# Autodesk Inventor assembly: MainBody_Assembly
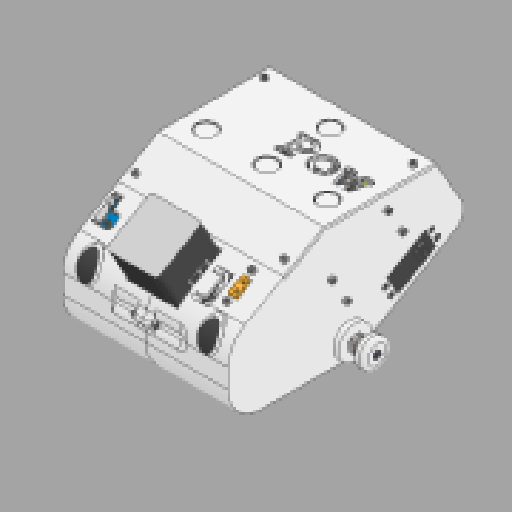
[picture p0: Inventor's stored thumbnail of the model, 512x512]
Saved by Autodesk Inventor 2025 (Build 290162000, 162)
## iProperties
Created: 2024-11-15
Part Number: MainBody_Assembly
Document SubType Name: Assembly
Designer: OSB
Mass: 1535.08 g
Surface Area: 4536.62 cm^2
Volume: 1058.16 cm^3
Density: 1.45071 g/cm^3
Sending System: Autodesk Inventor 2021
Preprocessor: unknown
Minimum Resolution: 0.01
Sent Units: Millimeter
Translation Standard: IGES 5.3
Model Creation Time: 2020-07-07
Title: S500 Frame
Author: OSB
## Documents named in this file (24)
- C:\Users\OSB\Desktop\SB\1.Projects\캡스톤 디자인(2)_Paper\Modeling\Implementation_Design\Ver_004_mass_update\MainBody_Assembly.iam
- C:\Users\OSB\Desktop\SB\1.Projects\캡스톤 디자인(2)_Paper\Modeling\Implementation_Design\Ver_004_mass_update\MainBody_Left.ipt
- C:\Users\OSB\Desktop\SB\1.Projects\캡스톤 디자인(2)_Paper\Modeling\Implementation_Design\Ver_004_mass_update\MainBody_Right.ipt
- C:\Users\OSB\Documents\Inventor\Content Center Files\R2025\ko-KR\KS B 1003\KS B 1003 - M 3 x 20.ipt
- C:\Users\OSB\Documents\Inventor\Content Center Files\R2025\ko-KR\KS B 1012  S2 F\KS B 1012 - M 3(1).ipt
- C:\Users\OSB\Desktop\SB\1.Projects\캡스톤 디자인(2)_Paper\Modeling\Implementation_Design\Ver_004_mass_update\BuckConverter_10A_Assembly.iam
- C:\Users\OSB\Desktop\SB\1.Projects\캡스톤 디자인(2)_Paper\Modeling\Implementation_Design\Ver_004_mass_update\BuckConverter_LM2596_Assembly.iam
- C:\Users\OSB\Desktop\SB\1.Projects\캡스톤 디자인(2)_Paper\Modeling\Implementation_Design\Ver_004_mass_update\InsertNut_M3.ipt
- C:\Users\OSB\Desktop\SB\1.Projects\캡스톤 디자인(2)_Paper\Modeling\Implementation_Design\Ver_004_mass_update\ESP32_Assembly.iam
- C:\Users\OSB\Desktop\SB\1.Projects\캡스톤 디자인(2)_Paper\Modeling\Implementation_Design\Ver_004_mass_update\MPU6050_Assembly.iam
- C:\Users\OSB\Desktop\SB\1.Projects\캡스톤 디자인(2)_Paper\Modeling\Implementation_Design\Ver_004_mass_update\Receiver_Assembly.ipt.iam
- C:\Users\OSB\Desktop\SB\1.Projects\캡스톤 디자인(2)_Paper\Modeling\Implementation_Design\Ver_004_mass_update\Servo_Hip_Assembly.iam
- C:\Users\OSB\Desktop\SB\1.Projects\캡스톤 디자인(2)_Paper\Modeling\Implementation_Design\Ver_004_mass_update\XT60_Assembly.ipt.iam
- C:\Users\OSB\Documents\Inventor\Content Center Files\R2025\ko-KR\KS B 1003\KS B 1003 - M 3 x 10.ipt
- C:\Users\OSB\Documents\Inventor\Content Center Files\R2025\ko-KR\KS B 1003\KS B 1003 - M 2.5 x 16.ipt
- C:\Users\OSB\Desktop\SB\1.Projects\캡스톤 디자인(2)_Paper\Modeling\Implementation_Design\Ver_004_mass_update\ShoulderBolt.ipt
- C:\Users\OSB\Desktop\SB\1.Projects\캡스톤 디자인(2)_Paper\Modeling\Implementation_Design\Ver_004_mass_update\Battery_LiPo_6S_Pack.ipt
- C:\Users\OSB\Desktop\SB\1.Projects\캡스톤 디자인(2)_Paper\Modeling\Implementation_Design\Ver_004_mass_update\MainBody_TopCover.ipt
- C:\Users\OSB\Desktop\SB\1.Projects\캡스톤 디자인(2)_Paper\Modeling\Implementation_Design\Ver_004_mass_update\Washer_6x12.5x1.ipt
- C:\Users\OSB\Documents\Inventor\Content Center Files\R2025\ko-KR\KS B 2023\KS B 2023 - 696 - 6 x 15 x 5 - 1.132.ipt
- C:\Users\OSB\Desktop\SB\1.Projects\캡스톤 디자인(2)_Paper\Modeling\Implementation_Design\Ver_004_mass_update\Spacer_Joint_Assembly.ipt.iam
- Receiver_Assembly.ipt
- XT60_Assembly.ipt
- Spacer_Joint_Assembly.ipt
## Components (67 placed, 20 different names)
1. MainBody_Left:1 — 회전:1, 메이트:1, 삽입:1, 삽입:2, 삽입:3, 삽입:4, 강체:3, 강체:4, 강체:7, 강체:8, 강체:9, 회전:3, 메이트:2, 메이트:5, 메이트:7, 회전:7, 메이트:10, 삽입:9, 삽입:10, 삽입:11, 삽입:12, 삽입:13, 삽입:14, 회전:8, 메이트:11, 삽입:21, 삽입:22, 삽입:23, 삽입:24, 강체:12, 메이트:13, 메이트:14, 강체:21
2. MainBody_Right:1 — 회전:1, 메이트:1, 삽입:5, 삽입:6, 삽입:7, 삽입:8, 강체:1, 강체:2, 강체:5, 강체:6, 강체:10, 회전:2, 메이트:3, 메이트:6, 회전:6, 메이트:9, 삽입:15, 삽입:16, 삽입:17, 삽입:18, 삽입:19, 삽입:20, 회전:9, 메이트:12, 삽입:25, 삽입:26, 삽입:27, 삽입:28, 강체:11, 메이트:15, 강체:22
3. MainBody_TopCover:1 — 회전:10, 메이트:16, 삽입:29, 삽입:30, 삽입:31, 삽입:32
4. Servo_Hip_Assembly:1 [sub-assembly] — 회전:8, 메이트:11
5. Servo_Hip_Assembly:2 [sub-assembly] — 회전:9, 메이트:12
6. BuckConverter_10A_Assembly:1 [sub-assembly] — 회전:3, 메이트:2
7. BuckConverter_10A_Assembly:2 [sub-assembly] — 회전:2, 메이트:3
8. BuckConverter_LM2596_Assembly:1 [sub-assembly] — 회전:4, 메이트:4
9. ESP32_Assembly:1 [sub-assembly] — 메이트:5, 메이트:6, 메이트:7
10. MPU6050_Assembly:1 [sub-assembly] — 회전:5, 메이트:8
11. Receiver_Assembly.ipt:1 [sub-assembly] — 회전:6, 메이트:9
12. XT60_Assembly.ipt:1 [sub-assembly] — 회전:7, 메이트:10
13. Battery_LiPo_6S_Pack:1 — 메이트:13, 메이트:14, 메이트:15
14. ShoulderBolt:1 — 강체:11
15. ShoulderBolt:2 — 강체:12
16. Washer_6x12.5x1:1 — 강체:15, 강체:22
17. Washer_6x12.5x1:2 — 강체:16, 강체:21
18. Washer_6x12.5x1:3 — 강체:17, 강체:20
19. Washer_6x12.5x1:4 — 강체:18, 강체:19
20. KS B 2023 696 - 6 x 15 x 5:1 — 강체:13, 강체:17
21. KS B 2023 696 - 6 x 15 x 5:2 — 강체:13, 강체:15
22. KS B 2023 696 - 6 x 15 x 5:3 — 강체:14, 강체:16
23. KS B 2023 696 - 6 x 15 x 5:4 — 강체:14, 강체:18
24. Spacer_Joint_Assembly.ipt:1 [sub-assembly] — 강체:19
25. Spacer_Joint_Assembly.ipt:2 [sub-assembly] — 강체:20
26. KS B 1003 - 미터 M 3 x 20:1 — 삽입:1
27. KS B 1003 - 미터 M 3 x 20:2 — 삽입:2
28. KS B 1003 - 미터 M 3 x 20:3 — 삽입:3
29. KS B 1003 - 미터 M 3 x 20:4 — 삽입:4
30. KS B 1003 - 미터 M 3 x 10:13 — 삽입:29
31. KS B 1003 - 미터 M 3 x 10:14 — 삽입:30
32. KS B 1003 - 미터 M 3 x 10:15 — 삽입:31
33. KS B 1003 - 미터 M 3 x 10:16 — 삽입:32
34. KS B 1003 - 미터 M 3 x 10:1 — 삽입:9
35. KS B 1003 - 미터 M 3 x 10:2 — 삽입:10
36. KS B 1003 - 미터 M 3 x 10:3 — 삽입:11
37. KS B 1003 - 미터 M 3 x 10:4 — 삽입:12
38. KS B 1003 - 미터 M 3 x 10:6 — 삽입:13
39. KS B 1003 - 미터 M 3 x 10:5 — 삽입:14
40. KS B 1003 - 미터 M 3 x 10:7 — 삽입:15
41. KS B 1003 - 미터 M 3 x 10:12 — 삽입:16
42. KS B 1003 - 미터 M 3 x 10:11 — 삽입:17
43. KS B 1003 - 미터 M 3 x 10:8 — 삽입:18
44. KS B 1003 - 미터 M 3 x 10:9 — 삽입:19
45. KS B 1003 - 미터 M 3 x 10:10 — 삽입:20
46. KS B 1003 - 미터 M 2.5 x 16:8 — 삽입:21
47. KS B 1003 - 미터 M 2.5 x 16:7 — 삽입:22
48. KS B 1003 - 미터 M 2.5 x 16:6 — 삽입:23
49. KS B 1003 - 미터 M 2.5 x 16:5 — 삽입:24
50. KS B 1003 - 미터 M 2.5 x 16:1 — 삽입:25
51. KS B 1003 - 미터 M 2.5 x 16:4 — 삽입:26
52. KS B 1003 - 미터 M 2.5 x 16:2 — 삽입:27
53. KS B 1003 - 미터 M 2.5 x 16:3 — 삽입:28
54. InsertNut_M3:1 — 강체:5
55. InsertNut_M3:2 — 강체:4, 회전:10
56. InsertNut_M3:3 — 강체:1, 메이트:16
57. InsertNut_M3:4 — 강체:3
58. InsertNut_M3:5 — 강체:2
59. InsertNut_M3:6 — 강체:6, 메이트:4
60. InsertNut_M3:7 — 강체:7, 회전:4
61. InsertNut_M3:8 — 강체:8
62. InsertNut_M3:9 — 강체:9, 메이트:8
63. InsertNut_M3:10 — 강체:10, 회전:5
64. KS B 1012 스타일 2 다듬질 - 미터 M 3:1 — 삽입:5
65. KS B 1012 스타일 2 다듬질 - 미터 M 3:2 — 삽입:6
66. KS B 1012 스타일 2 다듬질 - 미터 M 3:3 — 삽입:7
67. KS B 1012 스타일 2 다듬질 - 미터 M 3:4 — 삽입:8
## Relationships (80: Insert 32, WeldJoint 22, Mate 16, RevoluteJoint 10)
- 회전:1 [RevoluteJoint]: MainBody_Left:1 ↔ MainBody_Right:1
- 메이트:1 [Mate]: MainBody_Left:1 ↔ MainBody_Right:1
- 삽입:1 [Insert]: MainBody_Left:1 ↔ KS B 1003 - 미터 M 3 x 20:1
- 삽입:2 [Insert]: MainBody_Left:1 ↔ KS B 1003 - 미터 M 3 x 20:2
- 삽입:3 [Insert]: MainBody_Left:1 ↔ KS B 1003 - 미터 M 3 x 20:3
- 삽입:4 [Insert]: MainBody_Left:1 ↔ KS B 1003 - 미터 M 3 x 20:4
- 삽입:5 [Insert]: MainBody_Right:1 ↔ KS B 1012 스타일 2 다듬질 - 미터 M 3:1
- 삽입:6 [Insert]: MainBody_Right:1 ↔ KS B 1012 스타일 2 다듬질 - 미터 M 3:2
- 삽입:7 [Insert]: MainBody_Right:1 ↔ KS B 1012 스타일 2 다듬질 - 미터 M 3:3
- 삽입:8 [Insert]: MainBody_Right:1 ↔ KS B 1012 스타일 2 다듬질 - 미터 M 3:4
- 강체:1 [WeldJoint]: MainBody_Right:1 ↔ InsertNut_M3:3
- 강체:2 [WeldJoint]: MainBody_Right:1 ↔ InsertNut_M3:5
- 강체:3 [WeldJoint]: MainBody_Left:1 ↔ InsertNut_M3:4
- 강체:4 [WeldJoint]: MainBody_Left:1 ↔ InsertNut_M3:2
- 강체:5 [WeldJoint]: MainBody_Right:1 ↔ InsertNut_M3:1
- 강체:6 [WeldJoint]: MainBody_Right:1 ↔ InsertNut_M3:6
- 강체:7 [WeldJoint]: MainBody_Left:1 ↔ InsertNut_M3:7
- 강체:8 [WeldJoint]: MainBody_Left:1 ↔ InsertNut_M3:8
- 강체:9 [WeldJoint]: MainBody_Left:1 ↔ InsertNut_M3:9
- 강체:10 [WeldJoint]: MainBody_Right:1 ↔ InsertNut_M3:10
- 회전:2 [RevoluteJoint]: MainBody_Right:1 ↔ BuckConverter_10A_Assembly:2
- 회전:3 [RevoluteJoint]: MainBody_Left:1 ↔ BuckConverter_10A_Assembly:1
- 메이트:2 [Mate]: MainBody_Left:1 ↔ BuckConverter_10A_Assembly:1
- 메이트:3 [Mate]: MainBody_Right:1 ↔ BuckConverter_10A_Assembly:2
- 회전:4 [RevoluteJoint]: BuckConverter_LM2596_Assembly:1 ↔ InsertNut_M3:7
- 메이트:4 [Mate]: BuckConverter_LM2596_Assembly:1 ↔ InsertNut_M3:6
- 메이트:5 [Mate]: MainBody_Left:1 ↔ ESP32_Assembly:1
- 메이트:6 [Mate] (0.25 mm): MainBody_Right:1 ↔ ESP32_Assembly:1
- 메이트:7 [Mate] (0.5 mm): MainBody_Left:1 ↔ ESP32_Assembly:1
- 회전:5 [RevoluteJoint]: MPU6050_Assembly:1 ↔ InsertNut_M3:10
- 메이트:8 [Mate]: MPU6050_Assembly:1 ↔ InsertNut_M3:9
- 회전:6 [RevoluteJoint]: MainBody_Right:1 ↔ Receiver_Assembly.ipt:1
- 메이트:9 [Mate]: MainBody_Right:1 ↔ Receiver_Assembly.ipt:1
- 회전:7 [RevoluteJoint]: MainBody_Left:1 ↔ XT60_Assembly.ipt:1
- 메이트:10 [Mate]: MainBody_Left:1 ↔ XT60_Assembly.ipt:1
- 삽입:9 [Insert]: MainBody_Left:1 ↔ KS B 1003 - 미터 M 3 x 10:1
- 삽입:10 [Insert]: MainBody_Left:1 ↔ KS B 1003 - 미터 M 3 x 10:2
- 삽입:11 [Insert]: MainBody_Left:1 ↔ KS B 1003 - 미터 M 3 x 10:3
- 삽입:12 [Insert]: MainBody_Left:1 ↔ KS B 1003 - 미터 M 3 x 10:4
- 삽입:13 [Insert]: MainBody_Left:1 ↔ KS B 1003 - 미터 M 3 x 10:6
- 삽입:14 [Insert]: MainBody_Left:1 ↔ KS B 1003 - 미터 M 3 x 10:5
- 삽입:15 [Insert]: MainBody_Right:1 ↔ KS B 1003 - 미터 M 3 x 10:7
- 삽입:16 [Insert]: MainBody_Right:1 ↔ KS B 1003 - 미터 M 3 x 10:12
- 삽입:17 [Insert]: MainBody_Right:1 ↔ KS B 1003 - 미터 M 3 x 10:11
- 삽입:18 [Insert]: MainBody_Right:1 ↔ KS B 1003 - 미터 M 3 x 10:8
- 삽입:19 [Insert]: MainBody_Right:1 ↔ KS B 1003 - 미터 M 3 x 10:9
- 삽입:20 [Insert]: MainBody_Right:1 ↔ KS B 1003 - 미터 M 3 x 10:10
- 회전:8 [RevoluteJoint]: MainBody_Left:1 ↔ Servo_Hip_Assembly:1
- 메이트:11 [Mate]: MainBody_Left:1 ↔ Servo_Hip_Assembly:1
- 회전:9 [RevoluteJoint]: MainBody_Right:1 ↔ Servo_Hip_Assembly:2
- 메이트:12 [Mate]: MainBody_Right:1 ↔ Servo_Hip_Assembly:2
- 삽입:21 [Insert]: MainBody_Left:1 ↔ KS B 1003 - 미터 M 2.5 x 16:8
- 삽입:22 [Insert]: MainBody_Left:1 ↔ KS B 1003 - 미터 M 2.5 x 16:7
- 삽입:23 [Insert]: MainBody_Left:1 ↔ KS B 1003 - 미터 M 2.5 x 16:6
- 삽입:24 [Insert]: MainBody_Left:1 ↔ KS B 1003 - 미터 M 2.5 x 16:5
- 삽입:25 [Insert]: MainBody_Right:1 ↔ KS B 1003 - 미터 M 2.5 x 16:1
- 삽입:26 [Insert]: MainBody_Right:1 ↔ KS B 1003 - 미터 M 2.5 x 16:4
- 삽입:27 [Insert]: MainBody_Right:1 ↔ KS B 1003 - 미터 M 2.5 x 16:2
- 삽입:28 [Insert]: MainBody_Right:1 ↔ KS B 1003 - 미터 M 2.5 x 16:3
- 강체:11 [WeldJoint]: MainBody_Right:1 ↔ ShoulderBolt:1
- 강체:12 [WeldJoint]: MainBody_Left:1 ↔ ShoulderBolt:2
- 메이트:13 [Mate]: MainBody_Left:1 ↔ Battery_LiPo_6S_Pack:1
- 메이트:14 [Mate]: MainBody_Left:1 ↔ Battery_LiPo_6S_Pack:1
- 메이트:15 [Mate]: MainBody_Right:1 ↔ Battery_LiPo_6S_Pack:1
- 회전:10 [RevoluteJoint]: MainBody_TopCover:1 ↔ InsertNut_M3:2
- 메이트:16 [Mate]: MainBody_TopCover:1 ↔ InsertNut_M3:3
- 삽입:29 [Insert]: MainBody_TopCover:1 ↔ KS B 1003 - 미터 M 3 x 10:13
- 삽입:30 [Insert]: MainBody_TopCover:1 ↔ KS B 1003 - 미터 M 3 x 10:14
- 삽입:31 [Insert]: MainBody_TopCover:1 ↔ KS B 1003 - 미터 M 3 x 10:15
- 삽입:32 [Insert]: MainBody_TopCover:1 ↔ KS B 1003 - 미터 M 3 x 10:16
- 강체:13 [WeldJoint]: KS B 2023 696 - 6 x 15 x 5:1 ↔ KS B 2023 696 - 6 x 15 x 5:2
- 강체:14 [WeldJoint]: KS B 2023 696 - 6 x 15 x 5:3 ↔ KS B 2023 696 - 6 x 15 x 5:4
- 강체:15 [WeldJoint]: Washer_6x12.5x1:1 ↔ KS B 2023 696 - 6 x 15 x 5:2
- 강체:16 [WeldJoint]: Washer_6x12.5x1:2 ↔ KS B 2023 696 - 6 x 15 x 5:3
- 강체:17 [WeldJoint]: Washer_6x12.5x1:3 ↔ KS B 2023 696 - 6 x 15 x 5:1
- 강체:18 [WeldJoint]: Washer_6x12.5x1:4 ↔ KS B 2023 696 - 6 x 15 x 5:4
- 강체:21 [WeldJoint]: MainBody_Left:1 ↔ Washer_6x12.5x1:2
- 강체:22 [WeldJoint]: MainBody_Right:1 ↔ Washer_6x12.5x1:1
- 강체:20 [WeldJoint]: Washer_6x12.5x1:3 ↔ Spacer_Joint_Assembly.ipt:2
- 강체:19 [WeldJoint]: Washer_6x12.5x1:4 ↔ Spacer_Joint_Assembly.ipt:1
